# Autodesk Inventor assembly: WheeledBipedalRobot_Assembly
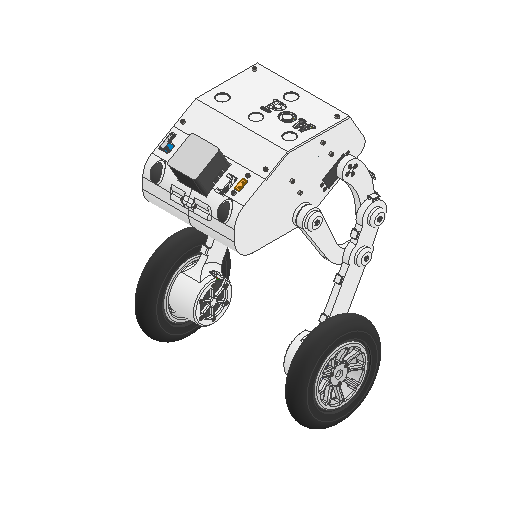
[picture p0: Inventor's stored thumbnail of the model, 512x512]
Saved by Autodesk Inventor 2025 (Build 290162000, 162)
## iProperties
Created: 2024-11-15
Part Number: WheeledBipedalRobot_Assembly
Document SubType Name: Assembly
Designer: OSB
Mass: 2775.84 g
Surface Area: 7859.26 cm^2
Volume: 2221.09 cm^3
Density: 1.24976 g/cm^3
Sending System: Autodesk Inventor 2021
Preprocessor: unknown
Minimum Resolution: 0.01
Sent Units: Millimeter
Translation Standard: IGES 5.3
Model Creation Time: 2020-07-07
Title: S500 Frame
Author: OSB
## Documents named in this file (10)
- C:\Users\OSB\Desktop\SB\1.Projects\캡스톤 디자인(2)_Paper\Modeling\Implementation_Design\Ver_004_mass_update\WheeledBipedalRobot_Assembly.iam
- C:\Users\OSB\Desktop\SB\1.Projects\캡스톤 디자인(2)_Paper\Modeling\Implementation_Design\Ver_004_mass_update\MainBody_Assembly.iam
- C:\Users\OSB\Desktop\SB\1.Projects\캡스톤 디자인(2)_Paper\Modeling\Implementation_Design\Ver_004_mass_update\ThighLink_Active_Left_Assembly.iam
- C:\Users\OSB\Desktop\SB\1.Projects\캡스톤 디자인(2)_Paper\Modeling\Implementation_Design\Ver_004_mass_update\ThighLink_Active_Right_Assembly.iam
- C:\Users\OSB\Desktop\SB\1.Projects\캡스톤 디자인(2)_Paper\Modeling\Implementation_Design\Ver_004_mass_update\ThighLink_Passive_Left_Assembly.iam
- C:\Users\OSB\Desktop\SB\1.Projects\캡스톤 디자인(2)_Paper\Modeling\Implementation_Design\Ver_004_mass_update\ThighLink_Passive_Right_Assembly.iam
- C:\Users\OSB\Desktop\SB\1.Projects\캡스톤 디자인(2)_Paper\Modeling\Implementation_Design\Ver_004_mass_update\Calf_Link_Left_Assembly.iam
- C:\Users\OSB\Desktop\SB\1.Projects\캡스톤 디자인(2)_Paper\Modeling\Implementation_Design\Ver_004_mass_update\Calf_Link_Right_Assembly.iam
- C:\Users\OSB\Desktop\SB\1.Projects\캡스톤 디자인(2)_Paper\Modeling\Implementation_Design\Ver_004_mass_update\Wheel_Assembly.iam
- C:\Users\OSB\Desktop\SB\1.Projects\캡스톤 디자인(2)_Paper\Modeling\Implementation_Design\Ver_004_mass_update\Wheel_Assembly_Right.iam
## Components (9 placed, 9 different names)
1. MainBody_Assembly:1 [sub-assembly] — 회전:2, 회전:4, 회전:9, 회전:11
2. ThighLink_Active_Left_Assembly:1 [sub-assembly] — 회전:2, 각도:1, 회전:10
3. ThighLink_Active_Right_Assembly:1 [sub-assembly] — 회전:4, 각도:2, 회전:12
4. ThighLink_Passive_Left_Assembly:1 [sub-assembly] — 회전:9, 메이트:5
5. ThighLink_Passive_Right_Assembly:1 [sub-assembly] — 회전:11, 메이트:6
6. Calf_Link_Left_Assembly:1 [sub-assembly] — 회전:7, 메이트:3, 회전:10, 메이트:5, 플러쉬:1
7. Calf_Link_Right_Assembly:1 [sub-assembly] — 회전:12, 메이트:6, 회전:13, 메이트:7, 플러쉬:1
8. Wheel_Assembly:1 [sub-assembly] — 회전:7, 메이트:3
9. Wheel_Assembly_Right:1 [sub-assembly] — 회전:13, 메이트:7
## Relationships (15: RevoluteJoint 8, Mate 4, Angle 2, Flush 1)
- 회전:2 [RevoluteJoint]: MainBody_Assembly:1 ↔ ThighLink_Active_Left_Assembly:1
- 회전:4 [RevoluteJoint]: MainBody_Assembly:1 ↔ ThighLink_Active_Right_Assembly:1
- 회전:7 [RevoluteJoint]: Calf_Link_Left_Assembly:1 ↔ Wheel_Assembly:1
- 메이트:3 [Mate]: Calf_Link_Left_Assembly:1 ↔ Wheel_Assembly:1
- 각도:1 [Angle] (69.97 deg): ThighLink_Active_Left_Assembly:1
- 각도:2 [Angle] (0 deg): ThighLink_Active_Right_Assembly:1
- 회전:9 [RevoluteJoint]: MainBody_Assembly:1 ↔ ThighLink_Passive_Left_Assembly:1
- 회전:10 [RevoluteJoint]: ThighLink_Active_Left_Assembly:1 ↔ Calf_Link_Left_Assembly:1
- 메이트:5 [Mate]: ThighLink_Passive_Left_Assembly:1 ↔ Calf_Link_Left_Assembly:1
- 회전:11 [RevoluteJoint]: MainBody_Assembly:1 ↔ ThighLink_Passive_Right_Assembly:1
- 회전:12 [RevoluteJoint]: ThighLink_Active_Right_Assembly:1 ↔ Calf_Link_Right_Assembly:1
- 메이트:6 [Mate]: ThighLink_Passive_Right_Assembly:1 ↔ Calf_Link_Right_Assembly:1
- 회전:13 [RevoluteJoint]: Calf_Link_Right_Assembly:1 ↔ Wheel_Assembly_Right:1
- 메이트:7 [Mate]: Calf_Link_Right_Assembly:1 ↔ Wheel_Assembly_Right:1
- 플러쉬:1 [Flush]: Calf_Link_Left_Assembly:1 ↔ Calf_Link_Right_Assembly:1
